# Autodesk Inventor assembly: Assembly1
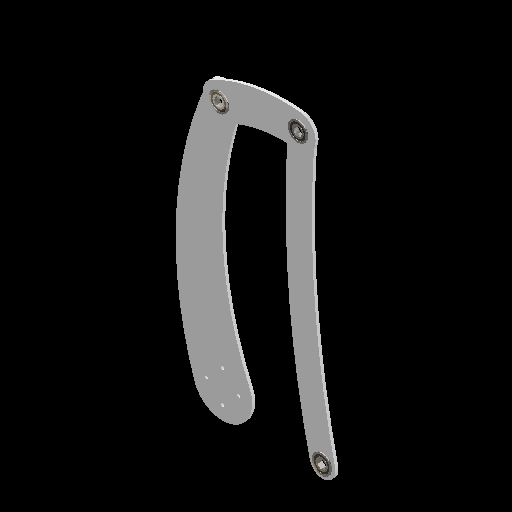
[picture p0: Inventor's stored thumbnail of the model, 512x512]
Saved by Autodesk Inventor 2027.1 (Build 311270010, 270A)
## iProperties
Created: 2026-11-13
Part Number: Assembly1
Document SubType Name: Assembly
Designer: Stanley Ruangsuwan
Author: Stanley Ruangsuwan
## Documents named in this file (5)
- C:\Users\stanr\Documents\GitHub\2026-2027-DesignTraining\Stan\hell (linkages)\New folder\Assembly1.iam
- C:\Users\stanr\Documents\GitHub\2026-2027-DesignTraining\Stan\hell (linkages)\New folder\Part1.ipt
- C:\Users\stanr\Documents\GitHub\2026-2027-DesignTraining\Stan\hell (linkages)\New folder\Part2.ipt
- C:\Users\stanr\Documents\GitHub\2026-2027-DesignTraining\Stan\hell (linkages)\New folder\Part3.ipt
- C:\Users\stanr\Documents\GitHub\2026-2027-DesignTraining\COTS Library\Motion\Bearings\COTS_WCP-0783_1.125ODHexBearing.ipt
## Components (6 placed, 4 different names)
1. Part2:1 — Mate:1, Mate:3, Mate:5
2. Part3:1 — Mate:2, Mate:3, Mate:4, Mate:5, Mate:6, Mate:8
3. COTS_WCP-0783_1.125ODHexBearing:1 — Mate:2, Mate:6, Mate:7
4. COTS_WCP-0783_1.125ODHexBearing:2 — Mate:1, Mate:4
5. COTS_WCP-0783_1.125ODHexBearing:3 — Mate:9, Mate:10
6. Part1:2 — Mate:7, Mate:8, Mate:9, Mate:10
## Relationships (10: Mate 10)
- Mate:1: Part2:1 ↔ COTS_WCP-0783_1.125ODHexBearing:2
- Mate:2: Part3:1 ↔ COTS_WCP-0783_1.125ODHexBearing:1
- Mate:3: Part2:1 ↔ Part3:1
- Mate:4: Part3:1 ↔ COTS_WCP-0783_1.125ODHexBearing:2
- Mate:5: Part2:1 ↔ Part3:1
- Mate:6: Part3:1 ↔ COTS_WCP-0783_1.125ODHexBearing:1
- Mate:7: COTS_WCP-0783_1.125ODHexBearing:1 ↔ Part1:2
- Mate:8: Part3:1 ↔ Part1:2
- Mate:9: COTS_WCP-0783_1.125ODHexBearing:3 ↔ Part1:2
- Mate:10: COTS_WCP-0783_1.125ODHexBearing:3 ↔ Part1:2
